# Autodesk Inventor assembly: Zespół1
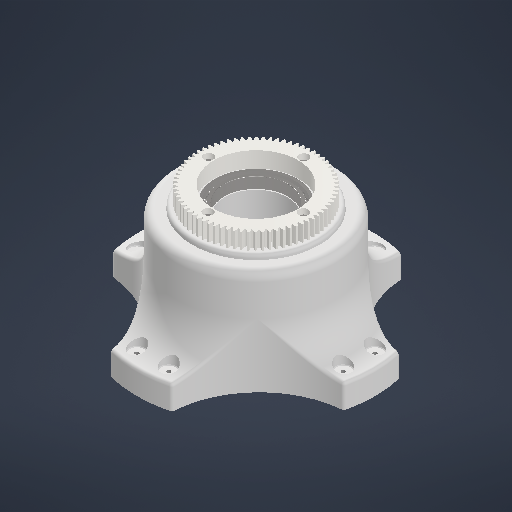
[picture p0: Inventor's stored thumbnail of the model, 512x512]
Saved by Autodesk Inventor 2026.1 (Build 301233020, 233B)
## iProperties
Created: 2025-10-22
Part Number: Zespół1
Document SubType Name: Assembly
Designer: Nitro
Author: Nitro
## Documents named in this file (6)
- C:\Users\Nitro\Pictures\Bryły\Zespół1.iam
- C:\Users\Nitro\Pictures\Bryły\22.10.2025-01.ipt
- C:\Users\Nitro\Pictures\Bryły\Zespół1\Design Accelerator\Łożysko1.iam
- C:\Users\Nitro\Pictures\Bryły\Zespół1\Design Accelerator\Przekładnie walcowe3.iam
- C:\Users\Nitro\Documents\Inventor\Content Center Files\R2026\pl-PL\BS 4168(1)\BS 4168 - M3 x 5(1).ipt
- C:\Users\Nitro\Documents\Inventor\Content Center Files\R2026\pl-PL\BS 4168(1)\BS 4168 - M3 x 16(1).ipt
## Components (7 placed, 5 different names)
1. 22.10.2025-01:1 — Wstawiające:1, Zestawiające:2
2. Łożysko:1 [sub-assembly] — Wstawiające:1, Zestawiające:1
3. Przekładnie walcowe:1 [sub-assembly] — Zestawiające:1, Zestawiające:2, Wstawiające:2, Wstawiające:3, Wstawiające:4, Wstawiające:5
4. BS 4168 : Element 1 Śruba z łbem o zmniejszonych z gniazdem sześciokątnym - Metryczny M3 x 5:1 — Wstawiające:2
5. BS 4168 : Element 1 Śruba z łbem o zmniejszonych z gniazdem sześciokątnym - Metryczny M3 x 5:2 — Wstawiające:3
6. BS 4168 : Element 1 Śruba z łbem o zmniejszonych z gniazdem sześciokątnym - Metryczny M3 x 16:1 — Wstawiające:4
7. BS 4168 : Element 1 Śruba z łbem o zmniejszonych z gniazdem sześciokątnym - Metryczny M3 x 5:4 — Wstawiające:5
## Relationships (7: Insert 5, Mate 2)
- Wstawiające:1 [Insert]: 22.10.2025-01:1 ↔ Łożysko:1
- Zestawiające:1 [Mate]: Łożysko:1 ↔ Przekładnie walcowe:1
- Zestawiające:2 [Mate]: 22.10.2025-01:1 ↔ Przekładnie walcowe:1
- Wstawiające:2 [Insert]: Przekładnie walcowe:1 ↔ BS 4168 : Element 1 Śruba z łbem o zmniejszonych z gniazdem sześciokątnym - Metryczny M3 x 5:1
- Wstawiające:3 [Insert]: Przekładnie walcowe:1 ↔ BS 4168 : Element 1 Śruba z łbem o zmniejszonych z gniazdem sześciokątnym - Metryczny M3 x 5:2
- Wstawiające:4 [Insert]: Przekładnie walcowe:1 ↔ BS 4168 : Element 1 Śruba z łbem o zmniejszonych z gniazdem sześciokątnym - Metryczny M3 x 16:1
- Wstawiające:5 [Insert]: Przekładnie walcowe:1 ↔ BS 4168 : Element 1 Śruba z łbem o zmniejszonych z gniazdem sześciokątnym - Metryczny M3 x 5:4
